# Autodesk Inventor assembly: RDS-GHN300-1000 Container
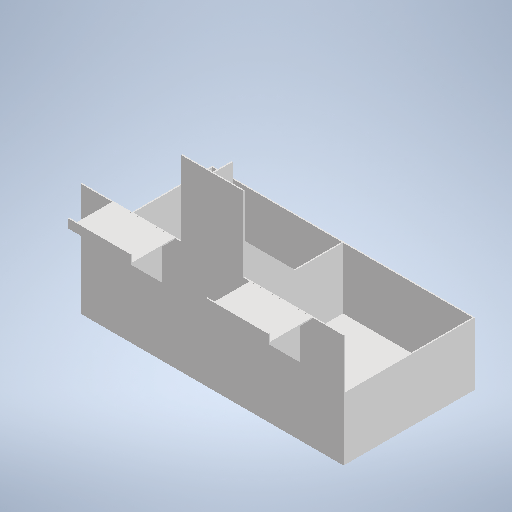
[picture p0: Inventor's stored thumbnail of the model, 512x512]
Saved by Autodesk Inventor 2026 (Build 300175000, 175)
## iProperties
Created: 2026-10-28
Part Number: RDS-GHN300-1000 Container
Document SubType Name: Assembly
Designer: user
Author: user
## Documents named in this file (7)
- C:\Users\user\Documents\Inventor\RDS-Reagent-Dosing-Station\RDS-GHN300 Reagent Dosing Station\RDS-GHN300-1000 Container.iam
- C:\Users\user\Documents\Inventor\RDS-Reagent-Dosing-Station\RDS-GHN300 Reagent Dosing Station\RDS-GHN300-1000 Container.ipt
- C:\Users\user\Documents\Inventor\RDS-Reagent-Dosing-Station\RDS-GHN300 Reagent Dosing Station\RDS-GHN300-1001 Container shelf.ipt
- C:\Users\user\Documents\Inventor\RDS-Reagent-Dosing-Station\RDS-GHN300 Reagent Dosing Station\RDS-GHN300-1002 Container shelf rib.ipt
- C:\Users\user\Documents\Inventor\RDS-Reagent-Dosing-Station\RDS-GHN300 Reagent Dosing Station\RDS-GHN300-1002 Container shelf rib2.ipt
- C:\Users\user\Documents\Inventor\RDS-Reagent-Dosing-Station\RDS-GHN300 Reagent Dosing Station\RDS-GHN300-1002 Container shelf rib3.ipt
- C:\Users\user\Documents\Inventor\RDS-Reagent-Dosing-Station\RDS-GHN300 Reagent Dosing Station\RDS-GHN300-1002 Container shelf rib4.ipt
## Components (7 placed, 6 different names)
1. RDS-GHN300-1000 Container:1 — Заподлицо:1, Совмещение:1, Заподлицо:2, Заподлицо:3, Совмещение:2, Заподлицо:4
2. RDS-GHN300-1001 Container shelf:1 — Заподлицо:1, Совмещение:1, Заподлицо:2, Жесткий:1, Жесткий:2
3. RDS-GHN300-1001 Container shelf:2 — Заподлицо:3, Совмещение:2, Заподлицо:4, Жесткий:3, Жесткий:4
4. RDS-GHN300-1002 Container shelf rib:1 — Жесткий:1
5. RDS-GHN300-1002 Container shelf rib2:1 — Жесткий:2
6. RDS-GHN300-1002 Container shelf rib3:1 — Жесткий:3
7. RDS-GHN300-1002 Container shelf rib4:1 — Жесткий:4
## Relationships (10: Flush 4, WeldJoint 4, Mate 2)
- Заподлицо:1 [Flush]: RDS-GHN300-1000 Container:1 ↔ RDS-GHN300-1001 Container shelf:1
- Совмещение:1 [Mate]: RDS-GHN300-1000 Container:1 ↔ RDS-GHN300-1001 Container shelf:1
- Заподлицо:2 [Flush] (250 mm): RDS-GHN300-1000 Container:1 ↔ RDS-GHN300-1001 Container shelf:1
- Заподлицо:3 [Flush]: RDS-GHN300-1000 Container:1 ↔ RDS-GHN300-1001 Container shelf:2
- Совмещение:2 [Mate]: RDS-GHN300-1000 Container:1 ↔ RDS-GHN300-1001 Container shelf:2
- Заподлицо:4 [Flush] (250 mm): RDS-GHN300-1000 Container:1 ↔ RDS-GHN300-1001 Container shelf:2
- Жесткий:1 [WeldJoint] (-100 mm): RDS-GHN300-1001 Container shelf:1 ↔ RDS-GHN300-1002 Container shelf rib:1
- Жесткий:2 [WeldJoint] (-100 mm): RDS-GHN300-1001 Container shelf:1 ↔ RDS-GHN300-1002 Container shelf rib2:1
- Жесткий:3 [WeldJoint] (-100 mm): RDS-GHN300-1001 Container shelf:2 ↔ RDS-GHN300-1002 Container shelf rib3:1
- Жесткий:4 [WeldJoint] (-100 mm): RDS-GHN300-1001 Container shelf:2 ↔ RDS-GHN300-1002 Container shelf rib4:1
